# Autodesk Inventor assembly: Assembly1
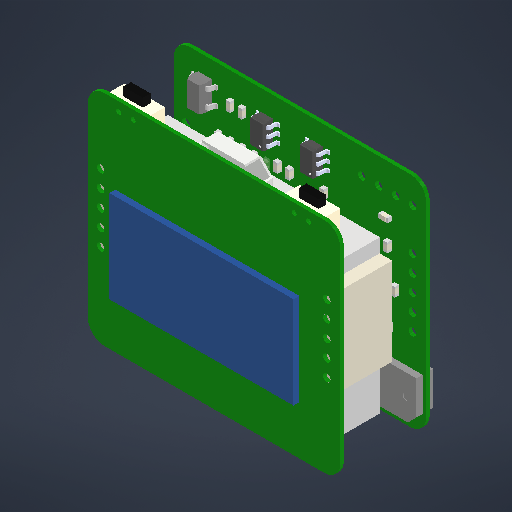
[picture p0: Inventor's stored thumbnail of the model, 512x512]
Saved by Autodesk Inventor 2027.2 (Build 312334000, 334)
## iProperties
Created: 2026-11-14
Part Number: Assembly1
Document SubType Name: Assembly
Designer: nikad
Author: nikad
## Documents named in this file (4)
- C:\Users\nikad\Downloads\stm32-lp-device\3D_Model\Assembly1.iam
- C:\Users\nikad\Downloads\stm32-lp-device\3D_Model\PCB1\PCB1.iam
- C:\Users\nikad\Downloads\stm32-lp-device\3D_Model\PCB2\PCB2.iam
- C:\Users\nikad\Downloads\stm32-lp-device\3D_Model\battery.ipt
## Components (3 placed, 3 different names)
1. PCB1:1 [sub-assembly] — Flush:1
2. PCB2:1 [sub-assembly] — Flush:1, Mate:2
3. battery:1 — Mate:2
## Relationships (2: Flush 1, Mate 1)
- Flush:1: PCB1:1 ↔ PCB2:1
- Mate:2 (3 mm): PCB2:1 ↔ battery:1
